# Autodesk Inventor assembly: top
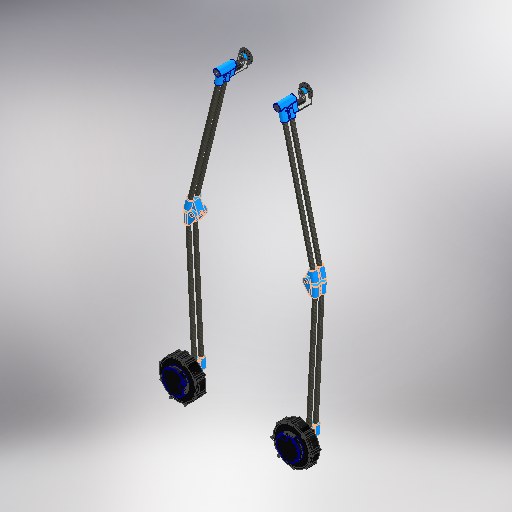
[picture p0: Inventor's stored thumbnail of the model, 512x512]
Saved by Autodesk Inventor 2025.3 (Build 293356030, 356C)
## iProperties
Created: 2026-02-11
Part Number: top
Document SubType Name: Assembly
Designer: ibuki_ono
Author: ibuki_ono
## Documents named in this file (10)
- C:\Users\ibuki_ono\Documents\hobby\rogiken\catchrobo\2026_CAD\Hardware_2026\Inventor\top_links\top.iam
- C:\Users\ibuki_ono\Documents\hobby\rogiken\catchrobo\2026_CAD\Hardware_2026\Inventor\top_links\Steadywin-GIM8108-8\8108-8安装图.iam
- C:\Users\ibuki_ono\Documents\hobby\rogiken\catchrobo\2026_CAD\Hardware_2026\Inventor\top_links\carbon-fai10-500mm.ipt
- C:\Users\ibuki_ono\Documents\hobby\rogiken\catchrobo\2026_CAD\Hardware_2026\Inventor\top_links\3D_carbon-with-angle.ipt
- C:\Users\ibuki_ono\Documents\hobby\rogiken\catchrobo\2026_CAD\Hardware_2026\Inventor\top_links\3D_carbon-with-angle2.ipt
- C:\Users\ibuki_ono\Documents\hobby\rogiken\catchrobo\2026_CAD\Hardware_2026\Inventor\top_links\SFL678ZZ.ipt
- C:\Users\ibuki_ono\Documents\hobby\rogiken\catchrobo\2026_CAD\Hardware_2026\Inventor\top_links\AS8.0_M6-spacer-30mm.ipt
- C:\Users\ibuki_ono\Documents\hobby\rogiken\catchrobo\2026_CAD\Hardware_2026\Inventor\base_table\3D_carbon-angle-top.ipt
- C:\Users\ibuki_ono\Documents\hobby\rogiken\catchrobo\2026_CAD\Hardware_2026\Inventor\top_links\3D_link-cover.ipt
- C:\Users\ibuki_ono\Documents\hobby\rogiken\catchrobo\2026_CAD\Hardware_2026\Inventor\top_links\3D_motor-cap.ipt
## Components (30 placed, 9 different names)
1. 8108-8安装图:1 [sub-assembly] — 挿入:35, 挿入:36, メイト:11
2. 8108-8安装图:2 [sub-assembly] — 挿入:37, 挿入:38, メイト:10
3. carbon-fai10-500mm:1 — 挿入:6, 挿入:8
4. carbon-fai10-500mm:2 — 挿入:7, 挿入:32
5. 3D_carbon-with-angle:1 — 挿入:3, 挿入:4, 挿入:5, 挿入:7, 挿入:12
6. 3D_carbon-with-angle2:1 — 挿入:1, 挿入:2, 挿入:6, メイト:1, メイト:4
7. SFL678ZZ:1 — 挿入:1, 挿入:4
8. SFL678ZZ:2 — 挿入:2, 挿入:3
9. AS8.0_M6-spacer-30mm:1 — 挿入:5
10. 3D_carbon-angle-top:1 — 挿入:8, 挿入:9, 挿入:10, 挿入:11, 挿入:13, 挿入:14, メイト:3, メイト:5, メイト:7
11. SFL678ZZ:3 — 挿入:9
12. SFL678ZZ:4 — 挿入:10
13. carbon-fai10-500mm:3 — 挿入:11, メイト:1
14. carbon-fai10-500mm:4 — 挿入:12, 挿入:31
15. 3D_link-cover:1 — 挿入:13, 挿入:14, フラッシュ:1
16. carbon-fai10-500mm:5 — 挿入:30
17. carbon-fai10-500mm:6 — 挿入:33
18. 3D_carbon-with-angle:2
19. 3D_carbon-with-angle2:2
20. SFL678ZZ:5
21. SFL678ZZ:6
22. AS8.0_M6-spacer-30mm:2
23. 3D_carbon-angle-top:2 — 挿入:29, 挿入:30, メイト:3, メイト:6, メイト:8
24. SFL678ZZ:7
25. SFL678ZZ:8
26. carbon-fai10-500mm:7 — 挿入:29
27. carbon-fai10-500mm:8 — 挿入:34
28. 3D_link-cover:2 — フラッシュ:1
29. 3D_motor-cap:1 — 挿入:31, 挿入:32, 挿入:37, 挿入:38, メイト:9
30. 3D_motor-cap:2 — 挿入:33, 挿入:34, 挿入:35, 挿入:36, メイト:9
## Relationships (48: Insert 36, Mate 11, Flush 1)
- 挿入:1 [Insert]: 3D_carbon-with-angle2:1 ↔ SFL678ZZ:1
- 挿入:2 [Insert]: 3D_carbon-with-angle2:1 ↔ SFL678ZZ:2
- 挿入:3 [Insert]: 3D_carbon-with-angle:1 ↔ SFL678ZZ:2
- 挿入:4 [Insert]: 3D_carbon-with-angle:1 ↔ SFL678ZZ:1
- 挿入:5 [Insert] (0.3 mm): 3D_carbon-with-angle:1 ↔ AS8.0_M6-spacer-30mm:1
- 挿入:6 [Insert]: carbon-fai10-500mm:1 ↔ 3D_carbon-with-angle2:1
- 挿入:7 [Insert]: carbon-fai10-500mm:2 ↔ 3D_carbon-with-angle:1
- 挿入:8 [Insert]: carbon-fai10-500mm:1 ↔ 3D_carbon-angle-top:1
- 挿入:9 [Insert]: 3D_carbon-angle-top:1 ↔ SFL678ZZ:3
- 挿入:10 [Insert]: 3D_carbon-angle-top:1 ↔ SFL678ZZ:4
- 挿入:11 [Insert]: 3D_carbon-angle-top:1 ↔ carbon-fai10-500mm:3
- メイト:1 [Mate]: 3D_carbon-with-angle2:1 ↔ carbon-fai10-500mm:3
- 挿入:12 [Insert]: 3D_carbon-with-angle:1 ↔ carbon-fai10-500mm:4
- 挿入:13 [Insert]: 3D_carbon-angle-top:1 ↔ 3D_link-cover:1
- 挿入:14 [Insert]: 3D_carbon-angle-top:1 ↔ 3D_link-cover:1
- [Insert]: 3D_carbon-with-angle2:2 ↔ SFL678ZZ:5
- [Insert]: 3D_carbon-with-angle2:2 ↔ SFL678ZZ:6
- [Insert]: 3D_carbon-with-angle:2 ↔ SFL678ZZ:6
- [Insert]: 3D_carbon-with-angle:2 ↔ SFL678ZZ:5
- [Insert] (0.3 mm): 3D_carbon-with-angle:2 ↔ AS8.0_M6-spacer-30mm:2
- [Insert]: carbon-fai10-500mm:5 ↔ 3D_carbon-with-angle2:2
- [Insert]: carbon-fai10-500mm:6 ↔ 3D_carbon-with-angle:2
- [Insert]: 3D_carbon-angle-top:2 ↔ SFL678ZZ:7
- [Insert]: 3D_carbon-angle-top:2 ↔ SFL678ZZ:8
- [Mate]: 3D_carbon-with-angle2:2 ↔ carbon-fai10-500mm:7
- [Insert]: 3D_carbon-with-angle:2 ↔ carbon-fai10-500mm:8
- [Insert]: 3D_carbon-angle-top:2 ↔ 3D_link-cover:2
- [Insert]: 3D_carbon-angle-top:2 ↔ 3D_link-cover:2
- 挿入:29 [Insert]: 3D_carbon-angle-top:2 ↔ carbon-fai10-500mm:7
- 挿入:30 [Insert]: carbon-fai10-500mm:5 ↔ 3D_carbon-angle-top:2
- フラッシュ:1 [Flush]: 3D_link-cover:1 ↔ 3D_link-cover:2
- メイト:3 [Mate] (148 mm): 3D_carbon-angle-top:1 ↔ 3D_carbon-angle-top:2
- メイト:4 [Mate]: 3D_carbon-with-angle2:1
- メイト:5 [Mate]: 3D_carbon-angle-top:1
- メイト:6 [Mate]: 3D_carbon-angle-top:2
- メイト:7 [Mate] (-74 mm): 3D_carbon-angle-top:1
- メイト:8 [Mate] (74 mm): 3D_carbon-angle-top:2
- 挿入:31 [Insert]: carbon-fai10-500mm:4 ↔ 3D_motor-cap:1
- 挿入:32 [Insert]: carbon-fai10-500mm:2 ↔ 3D_motor-cap:1
- 挿入:33 [Insert]: carbon-fai10-500mm:6 ↔ 3D_motor-cap:2
- 挿入:34 [Insert]: carbon-fai10-500mm:8 ↔ 3D_motor-cap:2
- 挿入:35 [Insert]: 8108-8安装图:1 ↔ 3D_motor-cap:2
- 挿入:36 [Insert]: 8108-8安装图:1 ↔ 3D_motor-cap:2
- 挿入:37 [Insert]: 8108-8安装图:2 ↔ 3D_motor-cap:1
- 挿入:38 [Insert]: 8108-8安装图:2 ↔ 3D_motor-cap:1
- メイト:9 [Mate] (280 mm): 3D_motor-cap:1 ↔ 3D_motor-cap:2
- メイト:10 [Mate] (-140 mm): 8108-8安装图:2
- メイト:11 [Mate] (140 mm): 8108-8安装图:1
## Named parameters: d15_d3 = 0 mm, d16_d4 = 0.3 mm, d17_d5 = 0 mm, d18_d6 = 0 mm, d20_d8 = 0 mm, d21_d9 = 0 mm, d23_d11 = 0 mm, d24_d12 = 0 mm, d25_d13 = 0 mm, d26_d14 = 0 mm, d27_d0 = 0 mm, d28_d1 = 0 mm, d29_d2 = 0 mm
